# Autodesk Inventor assembly: balcon
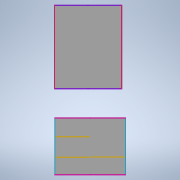
[picture p0: Inventor's stored thumbnail of the model, 180x180]
Saved by Autodesk Inventor 2022.6 (Build 266554000, 554)
## iProperties
Created: 2025-06-18
Part Number: balcon
Document SubType Name: Assembly
Designer: Dragos Macovei
Author: Dragos Macovei
## Documents named in this file (14)
- C:\Users\Dragos Macovei\Documents\Inventor_3d_parts\Draghie\balcon\balcon.iam
- C:\Users\Dragos Macovei\Documents\Inventor_3d_parts\Draghie\balcon\jos_sus_cutie_inferioara.ipt
- C:\Users\Dragos Macovei\Documents\Inventor_3d_parts\Draghie\balcon\stg_dr_cutie_inferioara.ipt
- C:\Users\Dragos Macovei\Documents\Inventor_3d_parts\Draghie\balcon\usa_cutie_inferioara.ipt
- C:\Users\Dragos Macovei\Documents\Inventor_3d_parts\Draghie\balcon\polita_cutie_inferioara.ipt
- C:\Users\Dragos Macovei\Documents\Inventor_3d_parts\Draghie\balcon\jos_sus_cutie_superioara.ipt
- C:\Users\Dragos Macovei\Documents\Inventor_3d_parts\Draghie\balcon\stg_dr_cutie_superioara.ipt
- C:\Users\Dragos Macovei\Documents\Inventor_3d_parts\Draghie\balcon\perete_despartitor_cutie_inferioara.ipt
- C:\Users\Dragos Macovei\Documents\Inventor_3d_parts\Draghie\balcon\prindere_pereti_laterali_corp_inferior.ipt
- C:\Users\Dragos Macovei\Documents\Inventor_3d_parts\Draghie\balcon\perete_despartitor_cutie_superioara.ipt
- C:\Users\Dragos Macovei\Documents\Inventor_3d_parts\Draghie\balcon\pfl_cutie_inferioara.ipt
- C:\Users\Dragos Macovei\Documents\Inventor_3d_parts\Draghie\balcon\usa_cutie_superioara.ipt
- C:\Users\Dragos Macovei\Documents\Inventor_3d_parts\Draghie\balcon\polita_cutie_superioara.ipt
- C:\Users\Dragos Macovei\Documents\Inventor_3d_parts\Draghie\balcon\pfl_cutie_superioara.ipt
## Components (25 placed, 13 different names)
1. jos_sus_cutie_inferioara:1 — Flush:6, Mate:3, Flush:7, Flush:13, Flush:14, Mate:14, Flush:21
2. jos_sus_cutie_inferioara:2 — Mate:1, Flush:1, Flush:2, Mate:2, Flush:3, Flush:4, Flush:10, Flush:11, Mate:11, Flush:16, Mate:19, Flush:25, Flush:32
3. stg_dr_cutie_inferioara:1 — Mate:1, Flush:1, Flush:2, Mate:4, Flush:8, Mate:17, Mate:18, Flush:23, Flush:24, Flush:33
4. stg_dr_cutie_inferioara:2 — Mate:2, Flush:3, Flush:4, Flush:6, Mate:3, Flush:7, Mate:5, Flush:9, Mate:15, Mate:16, Flush:22, Mate:20, Flush:31
5. usa_cutie_inferioara:1 — Mate:4, Flush:8, Flush:11
6. usa_cutie_inferioara:2 — Mate:5, Flush:9, Flush:10
7. polita_cutie_inferioara:1 — Flush:13, Mate:16, Flush:22
8. polita_cutie_inferioara:2 — Flush:14, Mate:17, Flush:24
9. polita_cutie_inferioara:3 — Mate:18, Flush:23
10. perete_despartitor_cutie_inferioara:1 — Mate:14, Flush:21, Mate:15, Mate:26
11. prindere_pereti_laterali_corp_inferior:1 — Mate:19, Mate:20, Flush:25
12. jos_sus_cutie_superioara:1 — Mate:11, Flush:16, Flush:19, Flush:20, Mate:21, Mate:22, Flush:26, Flush:27, Mate:24, Flush:30, Flush:41, Flush:43, Mate:34
13. jos_sus_cutie_superioara:2 — Mate:23, Flush:28, Flush:29, Mate:27, Flush:35, Flush:37, Mate:28, Flush:48
14. stg_dr_cutie_superioara:1 — Flush:20, Mate:21, Flush:27, Flush:28, Flush:29, Mate:25, Flush:34, Mate:31, Mate:32, Flush:44, Mate:33, Flush:45, Flush:46, Flush:47
15. stg_dr_cutie_superioara:2 — Flush:19, Mate:22, Flush:26, Mate:23, Flush:38, Mate:29, Mate:30, Flush:39, Flush:40
16. perete_despartitor_cutie_superioara:1 — Mate:24, Flush:30, Mate:25
17. pfl_cutie_inferioara:1 — Mate:26, Flush:31, Flush:32, Flush:33
18. usa_cutie_superioara:1 — Mate:27, Flush:34, Flush:35
19. usa_cutie_superioara:2 — Flush:37, Mate:28, Flush:38
20. polita_cutie_superioara:1 — Mate:29, Flush:40, Flush:41, Flush:42, Mate:37
21. polita_cutie_superioara:2 — Mate:30, Flush:39, Flush:42
22. polita_cutie_superioara:3 — Mate:31, Flush:43, Mate:34, Mate:35
23. polita_cutie_superioara:4 — Mate:32, Flush:44, Flush:46, Mate:35, Mate:36
24. polita_cutie_superioara:5 — Mate:33, Flush:45, Mate:36
25. pfl_cutie_superioara:1 — Mate:37, Flush:47, Flush:48
## Relationships (72: Flush 42, Mate 30)
- Mate:1: jos_sus_cutie_inferioara:2 ↔ stg_dr_cutie_inferioara:1
- Flush:1: jos_sus_cutie_inferioara:2 ↔ stg_dr_cutie_inferioara:1
- Flush:2: jos_sus_cutie_inferioara:2 ↔ stg_dr_cutie_inferioara:1
- Mate:2: jos_sus_cutie_inferioara:2 ↔ stg_dr_cutie_inferioara:2
- Flush:3: jos_sus_cutie_inferioara:2 ↔ stg_dr_cutie_inferioara:2
- Flush:4: jos_sus_cutie_inferioara:2 ↔ stg_dr_cutie_inferioara:2
- Flush:6: jos_sus_cutie_inferioara:1 ↔ stg_dr_cutie_inferioara:2
- Mate:3: jos_sus_cutie_inferioara:1 ↔ stg_dr_cutie_inferioara:2
- Flush:7: jos_sus_cutie_inferioara:1 ↔ stg_dr_cutie_inferioara:2
- Mate:4: stg_dr_cutie_inferioara:1 ↔ usa_cutie_inferioara:1
- Flush:8: stg_dr_cutie_inferioara:1 ↔ usa_cutie_inferioara:1
- Mate:5: stg_dr_cutie_inferioara:2 ↔ usa_cutie_inferioara:2
- Flush:9: stg_dr_cutie_inferioara:2 ↔ usa_cutie_inferioara:2
- Flush:10: jos_sus_cutie_inferioara:2 ↔ usa_cutie_inferioara:2
- Flush:11: jos_sus_cutie_inferioara:2 ↔ usa_cutie_inferioara:1
- Flush:13: jos_sus_cutie_inferioara:1 ↔ polita_cutie_inferioara:1
- Flush:14: jos_sus_cutie_inferioara:1 ↔ polita_cutie_inferioara:2
- Mate:11 (400 mm): jos_sus_cutie_inferioara:2 ↔ jos_sus_cutie_superioara:1
- Flush:16: jos_sus_cutie_inferioara:2 ↔ jos_sus_cutie_superioara:1
- Flush:19: jos_sus_cutie_superioara:1 ↔ stg_dr_cutie_superioara:2
- Flush:20: jos_sus_cutie_superioara:1 ↔ stg_dr_cutie_superioara:1
- Mate:14: jos_sus_cutie_inferioara:1 ↔ perete_despartitor_cutie_inferioara:1
- Flush:21: jos_sus_cutie_inferioara:1 ↔ perete_despartitor_cutie_inferioara:1
- Mate:15 (488 mm): stg_dr_cutie_inferioara:2 ↔ perete_despartitor_cutie_inferioara:1
- Mate:16: stg_dr_cutie_inferioara:2 ↔ polita_cutie_inferioara:1
- Flush:22: stg_dr_cutie_inferioara:2 ↔ polita_cutie_inferioara:1
- Mate:17: stg_dr_cutie_inferioara:1 ↔ polita_cutie_inferioara:2
- Mate:18: stg_dr_cutie_inferioara:1 ↔ polita_cutie_inferioara:3
- Flush:23: stg_dr_cutie_inferioara:1 ↔ polita_cutie_inferioara:3
- Flush:24: stg_dr_cutie_inferioara:1 ↔ polita_cutie_inferioara:2
- Mate:19: jos_sus_cutie_inferioara:2 ↔ prindere_pereti_laterali_corp_inferior:1
- Mate:20: stg_dr_cutie_inferioara:2 ↔ prindere_pereti_laterali_corp_inferior:1
- Flush:25: jos_sus_cutie_inferioara:2 ↔ prindere_pereti_laterali_corp_inferior:1
- Mate:21: jos_sus_cutie_superioara:1 ↔ stg_dr_cutie_superioara:1
- Mate:22: jos_sus_cutie_superioara:1 ↔ stg_dr_cutie_superioara:2
- Flush:26: jos_sus_cutie_superioara:1 ↔ stg_dr_cutie_superioara:2
- Flush:27: jos_sus_cutie_superioara:1 ↔ stg_dr_cutie_superioara:1
- Mate:23: jos_sus_cutie_superioara:2 ↔ stg_dr_cutie_superioara:2
- Flush:28: jos_sus_cutie_superioara:2 ↔ stg_dr_cutie_superioara:1
- Flush:29: jos_sus_cutie_superioara:2 ↔ stg_dr_cutie_superioara:1
- Mate:24: jos_sus_cutie_superioara:1 ↔ perete_despartitor_cutie_superioara:1
- Flush:30: jos_sus_cutie_superioara:1 ↔ perete_despartitor_cutie_superioara:1
- Mate:25 (463 mm): stg_dr_cutie_superioara:1 ↔ perete_despartitor_cutie_superioara:1
- Mate:26: perete_despartitor_cutie_inferioara:1 ↔ pfl_cutie_inferioara:1
- Flush:31: stg_dr_cutie_inferioara:2 ↔ pfl_cutie_inferioara:1
- Flush:32: jos_sus_cutie_inferioara:2 ↔ pfl_cutie_inferioara:1
- Flush:33: stg_dr_cutie_inferioara:1 ↔ pfl_cutie_inferioara:1
- Mate:27: jos_sus_cutie_superioara:2 ↔ usa_cutie_superioara:1
- Flush:34: stg_dr_cutie_superioara:1 ↔ usa_cutie_superioara:1
- Flush:35: jos_sus_cutie_superioara:2 ↔ usa_cutie_superioara:1
- Flush:37: jos_sus_cutie_superioara:2 ↔ usa_cutie_superioara:2
- Mate:28: jos_sus_cutie_superioara:2 ↔ usa_cutie_superioara:2
- Flush:38: stg_dr_cutie_superioara:2 ↔ usa_cutie_superioara:2
- Mate:29: stg_dr_cutie_superioara:2 ↔ polita_cutie_superioara:1
- Mate:30: stg_dr_cutie_superioara:2 ↔ polita_cutie_superioara:2
- Flush:39: stg_dr_cutie_superioara:2 ↔ polita_cutie_superioara:2
- Flush:40: stg_dr_cutie_superioara:2 ↔ polita_cutie_superioara:1
- Flush:41 (398 mm): jos_sus_cutie_superioara:1 ↔ polita_cutie_superioara:1
- Flush:42 (398 mm): polita_cutie_superioara:1 ↔ polita_cutie_superioara:2
- Mate:31: stg_dr_cutie_superioara:1 ↔ polita_cutie_superioara:3
- Flush:43: jos_sus_cutie_superioara:1 ↔ polita_cutie_superioara:3
- Mate:32: stg_dr_cutie_superioara:1 ↔ polita_cutie_superioara:4
- Flush:44: stg_dr_cutie_superioara:1 ↔ polita_cutie_superioara:4
- Mate:33: stg_dr_cutie_superioara:1 ↔ polita_cutie_superioara:5
- Flush:45: stg_dr_cutie_superioara:1 ↔ polita_cutie_superioara:5
- Flush:46: stg_dr_cutie_superioara:1 ↔ polita_cutie_superioara:4
- Mate:34 (190 mm): jos_sus_cutie_superioara:1 ↔ polita_cutie_superioara:3
- Mate:35 (380 mm): polita_cutie_superioara:3 ↔ polita_cutie_superioara:4
- Mate:36 (380 mm): polita_cutie_superioara:4 ↔ polita_cutie_superioara:5
- Mate:37: polita_cutie_superioara:1 ↔ pfl_cutie_superioara:1
- Flush:47: stg_dr_cutie_superioara:1 ↔ pfl_cutie_superioara:1
- Flush:48: jos_sus_cutie_superioara:2 ↔ pfl_cutie_superioara:1
